# Autodesk Inventor assembly: CartesianRobotWorkSpace
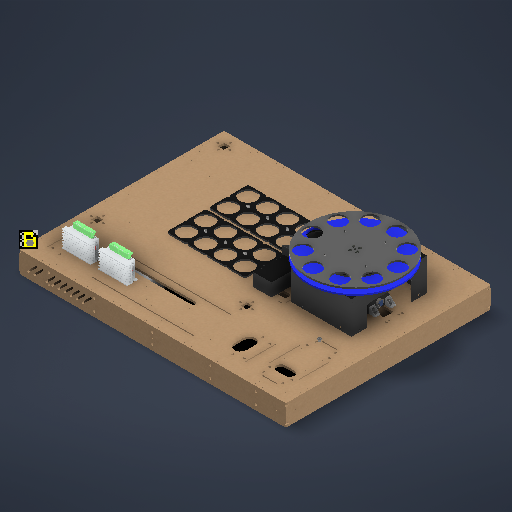
[picture p0: Inventor's stored thumbnail of the model, 512x512]
Saved by Autodesk Inventor 2027.1 (Build 311270010, 270A)
## iProperties
Created: 2026-09-29
Part Number: CartesianRobotWorkSpace
Document SubType Name: Assembly
Designer: SDS Scholar
Author: SDS Scholar
## Documents named in this file (37)
- C:\Users\Ahmed\Desktop\Fall 26\Design 1 Repo\MCT333_Design_of_Mechatronics_Systems_1\CAD\full_assembly\FullAssembly.iam
- C:\Users\Ahmed\Desktop\Fall 26\Design 1 Repo\MCT333_Design_of_Mechatronics_Systems_1\CAD\boxes\base_box\BaseBox.iam
- C:\Users\Ahmed\Desktop\Fall 26\Design 1 Repo\MCT333_Design_of_Mechatronics_Systems_1\CAD\cartesian_robot_workspace\CartesianRobotWorkSpace.iam
- C:\Users\Ahmed\Desktop\Fall 26\Design 1 Repo\MCT333_Design_of_Mechatronics_Systems_1\CAD\boxes\power_box\PowerBox.iam
- C:\Users\Ahmed\Desktop\Fall 26\Design 1 Repo\MCT333_Design_of_Mechatronics_Systems_1\CAD\FEED and Sorting\Assembly1.iam
- C:\Users\Ahmed\Desktop\Fall 26\Design 1 Repo\MCT333_Design_of_Mechatronics_Systems_1\CAD\boxes\control_box\ControlBox.iam
- C:\Users\Ahmed\Desktop\Fall 26\Design 1 Repo\MCT333_Design_of_Mechatronics_Systems_1\CAD\pnumatic_components\pneumatic_cylinder_double_action_mal16x75\AutodeskInventor\PneumaticAirCylinder.iam
- C:\Users\Ahmed\Desktop\Fall 26\Design 1 Repo\MCT333_Design_of_Mechatronics_Systems_1\CAD\FEED and Sorting\sorting_area\SortingArea.iam
- E:\Apps\AutodeskInventor\University\MCT333_Design_of_Mechatronics_Systems_1\CAD\electronic_components\esp32-38-pin-narrow-screw-terminal-breakout-board\ESP32 38 pin Screw terminal breakout board v11\ESP32 38 pi.ipt
- C:\Users\Ahmed\Desktop\Fall 26\Design 1 Repo\MCT333_Design_of_Mechatronics_Systems_1\CAD\motors_and_actuators\smakn-tb6600-stepper-motor-driver\SMAKN TB6600 Stepper Motor Driver\SMAKN TB6600 Stepper Motor Driver.ipt
- C:\Users\Ahmed\Desktop\Fall 26\Design 1 Repo\MCT333_Design_of_Mechatronics_Systems_1\CAD\motors_and_actuators\l298n-DC-motor-driver-red\L298N Stepper Motor Driver (Red)\L298N Stepper Motor Driver (Red).ipt
- C:\Users\Ahmed\Desktop\Fall 26\Design 1 Repo\MCT333_Design_of_Mechatronics_Systems_1\CAD\Product CAD\Product 1.iam
- C:\Users\Ahmed\Desktop\Fall 26\Design 1 Repo\MCT333_Design_of_Mechatronics_Systems_1\CAD\cartesian_robot_workspace\Z_Axis_1\Y Chain Path.ipt
- C:\Users\Ahmed\Desktop\Fall 26\Design 1 Repo\MCT333_Design_of_Mechatronics_Systems_1\CAD\cartesian_robot_workspace\Z_Axis_1\Drag Chain Middle Link.ipt
- C:\Users\Ahmed\Desktop\Fall 26\Design 1 Repo\MCT333_Design_of_Mechatronics_Systems_1\CAD\cartesian_robot_workspace\Z_Axis_1\X Chain Path.ipt
- C:\Users\Ahmed\Desktop\Fall 26\Design 1 Repo\MCT333_Design_of_Mechatronics_Systems_1\CAD\PowerDist_PCB_CAD\PowerDist_PCB_CAD.ipt
- C:\Users\Ahmed\Documents\Inventor\Content Center Files\R2027\en-US\ANSI B18.22 M\ANSI B18.22M - 5 N.ipt
- C:\Users\Ahmed\Documents\Inventor\Content Center Files\R2027\en-US\ANSI B18.22 M\ANSI B18.22M - 3 N.ipt
- C:\Users\SDS Scholar\Documents\Inventor\Content Center Files\R2027\en-US\ANSI B 18.2.4.1 M(1)\ANSI B 18.2.4.1 M - M3 x 0.5Style 1.ipt
- C:\Users\SDS Scholar\Documents\Inventor\Content Center Files\R2027\en-US\SS-ISO 4762\ISO 4762 - M3 x 16SS-ISO.ipt
- C:\Users\Ahmed\Desktop\Fall 26\Design 1 Repo\MCT333_Design_of_Mechatronics_Systems_1\CAD\electronic_components\esp32_38_pines\PCB_ESP32-38Pines\PCB_ESP32-38Pines.ipt
- C:\Users\Ahmed\Desktop\Fall 26\Design 1 Repo\MCT333_Design_of_Mechatronics_Systems_1\CAD\en-US\en-US\SS-ISO 4762\ISO 4762 - M5 x 16ISO.ipt
- C:\Users\SDS Scholar\Documents\Inventor\Content Center Files\R2027\en-US\ANSI B 18.2.4.1 M(1)\ANSI B 18.2.4.1 M - M5 x 0.8Style 2.ipt
- C:\Users\SDS Scholar\Documents\Inventor\Content Center Files\R2027\en-US\ANSI B18.22 M\ANSI B18.22M - 1.6 N.ipt
- C:\Users\SDS Scholar\Documents\Inventor\Content Center Files\R2027\en-US\ANSI B 18.2.4.1 M(1)\ANSI B 18.2.4.1 M - M1.6 x 0.35Style 1.ipt
- C:\Users\SDS Scholar\Documents\Inventor\Content Center Files\R2027\en-US\SS-ISO 4762\ISO 4762 - M1.6 x 12SS-ISO.ipt
- C:\Users\Ahmed\Desktop\Fall 26\Design 1 Repo\MCT333_Design_of_Mechatronics_Systems_1\CAD\fastners\nuts\ANSI B 18.2.4.1 M - M5 x 0.8Style 1.ipt
- C:\Users\SDS Scholar\Documents\Inventor\Content Center Files\R2027\en-US\BS EN ISO 7045 H\EN ISO 7045 - M5 x 20 - 4.8 - H(1).ipt
- C:\Users\Ahmed\Desktop\Fall 26\Design 1 Repo\MCT333_Design_of_Mechatronics_Systems_1\CAD\electronic_components\5v-laser-detection-receiver\Laser Detection Hardware\Laser Detection Hardware.ipt
- C:\Users\Ahmed\Desktop\Fall 26\Design 1 Repo\MCT333_Design_of_Mechatronics_Systems_1\CAD\pnumatic_components\4V110-06, 2 POSITION, 5 WAY SOLENOID VALVE\4V110-06, 2 POSITION, 5 WAY SOLENOID VALVE\4V110-06, 2 POSITION, 5 .ipt
- C:\Users\SDS Scholar\Documents\Inventor\Content Center Files\R2027\en-US\SS-ISO 4762\ISO 4762 - M3 x 30SS-ISO.ipt
- C:\Users\Ahmed\Documents\Inventor\Content Center Files\R2027\en-US\ISO 4032(2)\ISO 4032 - M3 - ISO.ipt
- C:\Users\Ahmed\Desktop\Fall 26\Design 1 Repo\MCT333_Design_of_Mechatronics_Systems_1\CAD\ZK06_vacuum_generator\ZK06_vacuum_generator.ipt
- C:\Users\SDS Scholar\Documents\Inventor\Content Center Files\R2027\en-US\ANSI B18.22 M\ANSI B18.22M - 3.5 N.ipt
- C:\Users\SDS Scholar\Documents\Inventor\Content Center Files\R2027\en-US\BS EN ISO 7045 H\EN ISO 7045 - M3.5 x 35 - 4.8 - H(1).ipt
- C:\Users\SDS Scholar\Documents\Inventor\Content Center Files\R2027\en-US\ANSI B 18.2.4.1 M(1)\ANSI B 18.2.4.1 M - M3.5 x 0.6Style 1.ipt
- C:\Users\Ahmed\Desktop\Fall 26\Design 1 Repo\MCT333_Design_of_Mechatronics_Systems_1\CAD\DESIGN1_CAD_parameters.xlsx
## Components (186 placed, 34 different names)
1. BaseBox:1 [sub-assembly] — Flush:1, Flush:2, Flush:3, Mate:1, Mate:2, Mate:3, Mate:4, Mate:5, Flush:4, Mate:6, Mate:7, Angle:2, Flush:7, Mate:16, Mate:17, Mate:20, Mate:21, Flush:23, Mate:23, Mate:32, Mate:35, Mate:38, Mate:40, Mate:41, Mate:44, Mate:45, Mate:46, Flush:10, Mate:55, Mate:56, Mate:86, Mate:94, Angle:8, Mate:109, Mate:111, Mate:121, Mate:123, Mate:131, Mate:154, Mate:155, Mate:156, Mate:157, Insert:3, Insert:4, Insert:5, Mate:159, Mate:167, Mate:169, Mate:170, Mate:171, Mate:177, Mate:178
2. CartesianRobotWorkSpace:1 [sub-assembly] — Mate:1, Mate:2, Mate:3, Mate:4, Mate:5, Flush:8, Angle:4, Angle:5, Flush:9, Angle:6, Angle:7, Mate:117, Mate:118, Mate:119, Mate:120
3. Assembly1:1 [sub-assembly] — Mate:177, Mate:178
4. Product 1:1 [sub-assembly] — Mate:40, Mate:41
5. 4V110-06, 2 POSITION, 5 :1 — Mate:155, Mate:156, Mate:157, Insert:1, Insert:2
6. SS ISO 4762 M3 x 30:1 — Insert:1
7. SS ISO 4762 M3 x 30:2 — Insert:2
8. ISO 4032 M3:1 — Insert:3
9. ISO 4032 M3:2 — Insert:4
10. ISO 4032 M3:3 — Insert:5
11. PneumaticAirCylinder:1 [sub-assembly] — Angle:2, Mate:38, Mate:45, Mate:46, Mate:129, Mate:130
12. Plain Washer (Metric) 5 N:5 — Mate:97
13. Plain Washer (Metric) 5 N:6 — Mate:98
14. Plain Washer (Metric) 5 N:7 — Mate:99
15. Plain Washer (Metric) 5 N:8 — Mate:100
16. Hex Nut Metric M5 x 0.8:1 — Mate:103
17. Hex Nut Metric M5 x 0.8:2 — Mate:101
18. Hex Nut Metric M5 x 0.8:3 — Mate:102
19. Hex Nut Metric M5 x 0.8:4 — Mate:104
20. PCB_ESP32-38Pines:2 — Mate:95, Flush:14, Flush:15
21. ISO 4762 M5 x 16:2 — Mate:100, Mate:104
22. ISO 4762 M5 x 16:3 — Mate:97, Mate:102
23. ISO 4762 M5 x 16:4 — Mate:99, Mate:101
24. ISO 4762 M5 x 16:1 — Mate:98, Mate:103
25. SMAKN TB6600 Stepper Motor Driver:1 — Mate:56, Mate:57, Flush:12
26. SMAKN TB6600 Stepper Motor Driver:2 — Mate:55, Mate:57, Flush:12, Flush:13, Mate:58
27. PowerDist_PCB_CAD:1 — Mate:44, Angle:8, Flush:10, Flush:11, Mate:83, Mate:84
28. PowerBox:1 [sub-assembly] — Flush:4, Mate:6, Mate:7, Mate:25, Mate:33
29. ESP32 38 pi:1 — Mate:23, Mate:25, Flush:11, Mate:95, Flush:14, Flush:15, Mate:105, Mate:106
30. L298N Stepper Motor Driver (Red):1 — Mate:32, Mate:33, Flush:13, Mate:58, Mate:89, Mate:90
31. PCB_ESP32-38Pines:1 — Mate:96, Flush:16, Flush:17
32. ControlBox:1 [sub-assembly] — Mate:20, Mate:21, Flush:23, Mate:36, Mate:37
33. ESP32 38 pi:2 — Mate:35, Mate:36, Mate:37, Mate:96, Flush:16, Flush:17, Mate:107, Mate:108
34. Y Chain Path:1 — Flush:8, Mate:42
35. X Chain Path:1 — Flush:9, Mate:43
36. SortingArea:1 [sub-assembly] — Flush:7, Mate:16, Mate:17, Mate:153
37. Laser Detection Hardware:1 — Mate:153
38. Laser Detection Hardware:2 — Mate:154
39. ZK06_vacuum_generator:1 — Mate:158, Mate:159, Mate:160, Mate:161, Mate:163, Mate:170, Mate:171
40. BS EN ISO 7045 H - Metric M3.5 x 35 - 4.8 - H:1 — Mate:158, Mate:164, Mate:166, Mate:172, Mate:175
41. BS EN ISO 7045 H - Metric M3.5 x 35 - 4.8 - H:2 — Mate:160, Mate:162, Mate:165, Mate:168, Mate:173
42. Plain Washer (Metric) 3.5 N:1 — Mate:163, Mate:164, Mate:166
43. Plain Washer (Metric) 3.5 N:2 — Mate:169, Mate:172, Mate:174, Mate:176
44. Plain Washer (Metric) 3.5 N:3 — Mate:161, Mate:162, Mate:165
45. Plain Washer (Metric) 3.5 N:4 — Mate:167, Mate:168
46. Hex Nut Metric M3.5 x 0.6:1 — Mate:173, Mate:174
47. Hex Nut Metric M3.5 x 0.6:2 — Mate:175, Mate:176
48. BS EN ISO 7045 H - Metric M5 x 20 - 4.8 - H:1 — Mate:119, Mate:120, Mate:124, Mate:126
49. BS EN ISO 7045 H - Metric M5 x 20 - 4.8 - H:2 — Mate:117, Mate:118, Mate:122, Mate:128
50. Plain Washer (Metric) 5 N:9 — Mate:123, Mate:124, Mate:125
51. Plain Washer (Metric) 5 N:10 — Mate:121, Mate:122, Mate:127
52. Hex Nut Metric M5 x 0.8:5 — Mate:127, Mate:128
53. Hex Nut Metric M5 x 0.8:6 — Mate:125, Mate:126
54. BS EN ISO 7045 H - Metric M5 x 20 - 4.8 - H:3
55. BS EN ISO 7045 H - Metric M5 x 20 - 4.8 - H:4
56. Plain Washer (Metric) 5 N:11
57. Plain Washer (Metric) 5 N:12
58. Hex Nut Metric M5 x 0.8:7
59. Hex Nut Metric M5 x 0.8:8
60. BS EN ISO 7045 H - Metric M5 x 20 - 4.8 - H:5
61. BS EN ISO 7045 H - Metric M5 x 20 - 4.8 - H:6
62. Plain Washer (Metric) 5 N:13
63. Plain Washer (Metric) 5 N:14
64. Hex Nut Metric M5 x 0.8:9
65. Hex Nut Metric M5 x 0.8:10
66. BS EN ISO 7045 H - Metric M5 x 20 - 4.8 - H:7
67. BS EN ISO 7045 H - Metric M5 x 20 - 4.8 - H:8
68. Plain Washer (Metric) 5 N:15
69. Plain Washer (Metric) 5 N:16
70. Hex Nut Metric M5 x 0.8:11
71. Hex Nut Metric M5 x 0.8:12
72. BS EN ISO 7045 H - Metric M5 x 20 - 4.8 - H:9 — Mate:129, Mate:130, Mate:132, Mate:134
73. Plain Washer (Metric) 5 N:17 — Mate:131, Mate:132, Mate:133
74. Hex Nut Metric M5 x 0.8:13 — Mate:133, Mate:134
75. BS EN ISO 7045 H - Metric M5 x 20 - 4.8 - H:10
76. Plain Washer (Metric) 5 N:18
77. Hex Nut Metric M5 x 0.8:14
78. BS EN ISO 7045 H - Metric M5 x 20 - 4.8 - H:11
79. Plain Washer (Metric) 5 N:19
80. Hex Nut Metric M5 x 0.8:15
81. BS EN ISO 7045 H - Metric M5 x 20 - 4.8 - H:12
82. Plain Washer (Metric) 5 N:20
83. Hex Nut Metric M5 x 0.8:16
84. SS ISO 4762 M1.6 x 12:2 — Mate:105, Mate:106, Mate:110, Mate:116
85. Plain Washer (Metric) 1.6 N:2 — Mate:109, Mate:110, Mate:115
86. Hex Nut Metric M1.6 x 0.35:2 — Mate:115, Mate:116
87. SS ISO 4762 M1.6 x 12:3
88. Plain Washer (Metric) 1.6 N:3
89. Hex Nut Metric M1.6 x 0.35:4
90. SS ISO 4762 M1.6 x 12:4
91. Plain Washer (Metric) 1.6 N:4
92. Hex Nut Metric M1.6 x 0.35:5
93. SS ISO 4762 M1.6 x 12:5
94. Plain Washer (Metric) 1.6 N:5
95. Hex Nut Metric M1.6 x 0.35:6
96. SS ISO 4762 M3 x 16:1 — Mate:83, Mate:84, Mate:85, Mate:87
97. Hex Nut Metric M3 x 0.5:1 — Mate:87, Mate:88
98. Plain Washer (Metric) 3 N:1 — Mate:85, Mate:86, Mate:88
99. SS ISO 4762 M3 x 16:2
100. Hex Nut Metric M3 x 0.5:2
101. Plain Washer (Metric) 3 N:2
102. SS ISO 4762 M3 x 16:3
103. Hex Nut Metric M3 x 0.5:3
104. Plain Washer (Metric) 3 N:3
105. SS ISO 4762 M3 x 16:4
106. Hex Nut Metric M3 x 0.5:4
107. Plain Washer (Metric) 3 N:4
108. SS ISO 4762 M3 x 16:5 — Mate:89, Mate:90, Mate:91, Mate:93
109. Hex Nut Metric M3 x 0.5:5 — Mate:92, Mate:93
110. Plain Washer (Metric) 3 N:5 — Mate:91, Mate:92, Mate:94
111. SS ISO 4762 M3 x 16:6
112. Hex Nut Metric M3 x 0.5:6
113. Plain Washer (Metric) 3 N:6
114. SS ISO 4762 M3 x 16:7
115. Hex Nut Metric M3 x 0.5:7
116. Plain Washer (Metric) 3 N:7
117. SS ISO 4762 M3 x 16:8
118. Hex Nut Metric M3 x 0.5:8
119. Plain Washer (Metric) 3 N:8
120. Plain Washer (Metric) 1.6 N:1 — Mate:111, Mate:112, Mate:113
121. Hex Nut Metric M1.6 x 0.35:3 — Mate:113, Mate:114
122. SS ISO 4762 M1.6 x 12:1 — Mate:107, Mate:108, Mate:112, Mate:114
123. Plain Washer (Metric) 1.6 N:6
124. Hex Nut Metric M1.6 x 0.35:7
125. SS ISO 4762 M1.6 x 12:6
126. Plain Washer (Metric) 1.6 N:7
127. Hex Nut Metric M1.6 x 0.35:8
128. SS ISO 4762 M1.6 x 12:7
129. Plain Washer (Metric) 1.6 N:8
130. Hex Nut Metric M1.6 x 0.35:9
131. SS ISO 4762 M1.6 x 12:8
132. Drag Chain Middle Link:1 — Mate:42, Angle:4, Angle:5
133. Drag Chain Middle Link:2
134. Drag Chain Middle Link:3
135. Drag Chain Middle Link:4
136. Drag Chain Middle Link:5
137. Drag Chain Middle Link:6
138. Drag Chain Middle Link:7
139. Drag Chain Middle Link:8
140. Drag Chain Middle Link:9
141. Drag Chain Middle Link:10
142. Drag Chain Middle Link:11
143. Drag Chain Middle Link:12
144. Drag Chain Middle Link:13
145. Drag Chain Middle Link:14
146. Drag Chain Middle Link:15
147. Drag Chain Middle Link:16
148. Drag Chain Middle Link:17
149. Drag Chain Middle Link:18
150. Drag Chain Middle Link:19
151. Drag Chain Middle Link:20
152. Drag Chain Middle Link:21
153. Drag Chain Middle Link:22
154. Drag Chain Middle Link:23
155. Drag Chain Middle Link:24
156. Drag Chain Middle Link:25
157. Drag Chain Middle Link:26
158. Drag Chain Middle Link:27
159. Drag Chain Middle Link:28
160. Drag Chain Middle Link:29
161. Drag Chain Middle Link:30
162. Drag Chain Middle Link:31 — Mate:43, Angle:6, Angle:7
163. Drag Chain Middle Link:32
164. Drag Chain Middle Link:33
165. Drag Chain Middle Link:34
166. Drag Chain Middle Link:35
167. Drag Chain Middle Link:36
168. Drag Chain Middle Link:37
169. Drag Chain Middle Link:38
170. Drag Chain Middle Link:39
171. Drag Chain Middle Link:40
172. Drag Chain Middle Link:41
173. Drag Chain Middle Link:42
174. Drag Chain Middle Link:43
175. Drag Chain Middle Link:44
176. Drag Chain Middle Link:45
177. Drag Chain Middle Link:46
178. Drag Chain Middle Link:47
179. Drag Chain Middle Link:48
180. Drag Chain Middle Link:49
181. Drag Chain Middle Link:50
182. Drag Chain Middle Link:51
183. Drag Chain Middle Link:52
184. Drag Chain Middle Link:53
185. Drag Chain Middle Link:54
186. Drag Chain Middle Link:55
## Component patterns: (4 elements, first: BS EN ISO 7045 H - Metric M5 x 20 - 4.8 - H:1 + BS EN ISO 7045 H - Metric M5 x 20 - 4.8 - H:2 + Plain Washer (Metric) 5 N:9 + Plain Washer (Metric) 5 N:10 + Hex Nut Metric M5 x 0.8:5 + Hex Nut Metric M5 x 0.8:6), (4 elements, first: BS EN ISO 7045 H - Metric M5 x 20 - 4.8 - H:9 + Plain Washer (Metric) 5 N:17 + Hex Nut Metric M5 x 0.8:13), (4 elements, first: SS ISO 4762 M1.6 x 12:2 + Plain Washer (Metric) 1.6 N:2 + Hex Nut Metric M1.6 x 0.35:2), (4 elements, first: SS ISO 4762 M3 x 16:1 + Hex Nut Metric M3 x 0.5:1 + Plain Washer (Metric) 3 N:1), (4 elements, first: SS ISO 4762 M3 x 16:5 + Hex Nut Metric M3 x 0.5:5 + Plain Washer (Metric) 3 N:5), (4 elements, first: Plain Washer (Metric) 1.6 N:1 + Hex Nut Metric M1.6 x 0.35:3 + SS ISO 4762 M1.6 x 12:1), (30 elements, first: Drag Chain Middle Link:1), (25 elements, first: Drag Chain Middle Link:31)
## Relationships (143: Mate 116, Flush 16, Angle 6, Insert 5)
- Flush:1: BaseBox:1
- Flush:2: BaseBox:1
- Flush:3: BaseBox:1
- Mate:1: BaseBox:1 ↔ CartesianRobotWorkSpace:1
- Mate:2: BaseBox:1 ↔ CartesianRobotWorkSpace:1
- Mate:3: BaseBox:1 ↔ CartesianRobotWorkSpace:1
- Mate:4: BaseBox:1 ↔ CartesianRobotWorkSpace:1
- Mate:5: BaseBox:1 ↔ CartesianRobotWorkSpace:1
- Flush:4: BaseBox:1 ↔ PowerBox:1
- Mate:6: BaseBox:1 ↔ PowerBox:1
- Mate:7: BaseBox:1 ↔ PowerBox:1
- Angle:2 (180 deg): BaseBox:1 ↔ PneumaticAirCylinder:1
- Flush:7: BaseBox:1 ↔ SortingArea:1
- Mate:16: BaseBox:1 ↔ SortingArea:1
- Mate:17: BaseBox:1 ↔ SortingArea:1
- Mate:20: BaseBox:1 ↔ ControlBox:1
- Mate:21: BaseBox:1 ↔ ControlBox:1
- Flush:23: BaseBox:1 ↔ ControlBox:1
- Mate:23: BaseBox:1 ↔ ESP32 38 pi:1
- Mate:25 (370 mm): PowerBox:1 ↔ ESP32 38 pi:1
- Mate:32: BaseBox:1 ↔ L298N Stepper Motor Driver (Red):1
- Mate:33 (30 mm): PowerBox:1 ↔ L298N Stepper Motor Driver (Red):1
- Mate:35: BaseBox:1 ↔ ESP32 38 pi:2
- Mate:36 (7.5 mm): ControlBox:1 ↔ ESP32 38 pi:2
- Mate:37 (10 mm): ControlBox:1 ↔ ESP32 38 pi:2
- Mate:38: BaseBox:1 ↔ PneumaticAirCylinder:1
- Mate:40: BaseBox:1 ↔ Product 1:1
- Mate:41: BaseBox:1 ↔ Product 1:1
- Flush:8: CartesianRobotWorkSpace:1 ↔ Y Chain Path:1
- Mate:42: Y Chain Path:1 ↔ Drag Chain Middle Link:1
- Angle:4 (0 deg): CartesianRobotWorkSpace:1 ↔ Drag Chain Middle Link:1
- Angle:5 (0 deg): CartesianRobotWorkSpace:1 ↔ Drag Chain Middle Link:1
- Flush:9: CartesianRobotWorkSpace:1 ↔ X Chain Path:1
- Mate:43: X Chain Path:1 ↔ Drag Chain Middle Link:31
- Angle:6 (0 deg): CartesianRobotWorkSpace:1 ↔ Drag Chain Middle Link:31
- Angle:7 (0 deg): CartesianRobotWorkSpace:1 ↔ Drag Chain Middle Link:31
- Mate:44: BaseBox:1 ↔ PowerDist_PCB_CAD:1
- Angle:8 (0 deg): BaseBox:1 ↔ PowerDist_PCB_CAD:1
- Mate:45: BaseBox:1 ↔ PneumaticAirCylinder:1
- Mate:46: BaseBox:1 ↔ PneumaticAirCylinder:1
- Flush:10 (20 mm): BaseBox:1 ↔ PowerDist_PCB_CAD:1
- Flush:11: PowerDist_PCB_CAD:1 ↔ ESP32 38 pi:1
- Mate:55: BaseBox:1 ↔ SMAKN TB6600 Stepper Motor Driver:2
- Mate:56: BaseBox:1 ↔ SMAKN TB6600 Stepper Motor Driver:1
- Mate:57 (40 mm): SMAKN TB6600 Stepper Motor Driver:1 ↔ SMAKN TB6600 Stepper Motor Driver:2
- Flush:12: SMAKN TB6600 Stepper Motor Driver:1 ↔ SMAKN TB6600 Stepper Motor Driver:2
- Flush:13: SMAKN TB6600 Stepper Motor Driver:2 ↔ L298N Stepper Motor Driver (Red):1
- Mate:58 (20 mm): SMAKN TB6600 Stepper Motor Driver:2 ↔ L298N Stepper Motor Driver (Red):1
- [Mate]: ISO 4762 M5 x 16:4 ↔ SMAKN TB6600 Stepper Motor Driver:2
- [Mate]: ISO 4762 M5 x 16:3 ↔ SMAKN TB6600 Stepper Motor Driver:2
- [Mate]: ISO 4762 M5 x 16:2 ↔ SMAKN TB6600 Stepper Motor Driver:1
- [Mate]: ISO 4762 M5 x 16:1 ↔ SMAKN TB6600 Stepper Motor Driver:1
- [Mate]: ISO 4762 M5 x 16:4 ↔ SMAKN TB6600 Stepper Motor Driver:2
- [Mate]: ISO 4762 M5 x 16:3 ↔ SMAKN TB6600 Stepper Motor Driver:2
- [Mate]: ISO 4762 M5 x 16:1 ↔ SMAKN TB6600 Stepper Motor Driver:1
- [Mate]: ISO 4762 M5 x 16:2 ↔ SMAKN TB6600 Stepper Motor Driver:1
- Mate:83: PowerDist_PCB_CAD:1 ↔ SS ISO 4762 M3 x 16:1
- Mate:84: PowerDist_PCB_CAD:1 ↔ SS ISO 4762 M3 x 16:1
- Mate:85: SS ISO 4762 M3 x 16:1 ↔ Plain Washer (Metric) 3 N:1
- Mate:86: BaseBox:1 ↔ Plain Washer (Metric) 3 N:1
- Mate:87: SS ISO 4762 M3 x 16:1 ↔ Hex Nut Metric M3 x 0.5:1
- Mate:88: Hex Nut Metric M3 x 0.5:1 ↔ Plain Washer (Metric) 3 N:1
- Mate:89: L298N Stepper Motor Driver (Red):1 ↔ SS ISO 4762 M3 x 16:5
- Mate:90: L298N Stepper Motor Driver (Red):1 ↔ SS ISO 4762 M3 x 16:5
- Mate:91: SS ISO 4762 M3 x 16:5 ↔ Plain Washer (Metric) 3 N:5
- Mate:92: Hex Nut Metric M3 x 0.5:5 ↔ Plain Washer (Metric) 3 N:5
- Mate:93: SS ISO 4762 M3 x 16:5 ↔ Hex Nut Metric M3 x 0.5:5
- Mate:94: BaseBox:1 ↔ Plain Washer (Metric) 3 N:5
- Mate:95: PCB_ESP32-38Pines:2 ↔ ESP32 38 pi:1
- Flush:14: PCB_ESP32-38Pines:2 ↔ ESP32 38 pi:1
- Flush:15: PCB_ESP32-38Pines:2 ↔ ESP32 38 pi:1
- Mate:96: PCB_ESP32-38Pines:1 ↔ ESP32 38 pi:2
- Flush:16: PCB_ESP32-38Pines:1 ↔ ESP32 38 pi:2
- Flush:17: PCB_ESP32-38Pines:1 ↔ ESP32 38 pi:2
- Mate:97: Plain Washer (Metric) 5 N:5 ↔ ISO 4762 M5 x 16:3
- Mate:98: Plain Washer (Metric) 5 N:6 ↔ ISO 4762 M5 x 16:1
- Mate:99: Plain Washer (Metric) 5 N:7 ↔ ISO 4762 M5 x 16:4
- Mate:100: Plain Washer (Metric) 5 N:8 ↔ ISO 4762 M5 x 16:2
- Mate:101: Hex Nut Metric M5 x 0.8:2 ↔ ISO 4762 M5 x 16:4
- Mate:102: Hex Nut Metric M5 x 0.8:3 ↔ ISO 4762 M5 x 16:3
- Mate:103: Hex Nut Metric M5 x 0.8:1 ↔ ISO 4762 M5 x 16:1
- Mate:104: Hex Nut Metric M5 x 0.8:4 ↔ ISO 4762 M5 x 16:2
- Mate:105: ESP32 38 pi:1 ↔ SS ISO 4762 M1.6 x 12:2
- Mate:106: ESP32 38 pi:1 ↔ SS ISO 4762 M1.6 x 12:2
- Mate:107: ESP32 38 pi:2 ↔ SS ISO 4762 M1.6 x 12:1
- Mate:108: ESP32 38 pi:2 ↔ SS ISO 4762 M1.6 x 12:1
- Mate:109: BaseBox:1 ↔ Plain Washer (Metric) 1.6 N:2
- Mate:110: SS ISO 4762 M1.6 x 12:2 ↔ Plain Washer (Metric) 1.6 N:2
- Mate:111: BaseBox:1 ↔ Plain Washer (Metric) 1.6 N:1
- Mate:112: Plain Washer (Metric) 1.6 N:1 ↔ SS ISO 4762 M1.6 x 12:1
- Mate:113: Plain Washer (Metric) 1.6 N:1 ↔ Hex Nut Metric M1.6 x 0.35:3
- Mate:114: Hex Nut Metric M1.6 x 0.35:3 ↔ SS ISO 4762 M1.6 x 12:1
- Mate:115: Plain Washer (Metric) 1.6 N:2 ↔ Hex Nut Metric M1.6 x 0.35:2
- Mate:116: SS ISO 4762 M1.6 x 12:2 ↔ Hex Nut Metric M1.6 x 0.35:2
- Mate:117: CartesianRobotWorkSpace:1 ↔ BS EN ISO 7045 H - Metric M5 x 20 - 4.8 - H:2
- Mate:118: CartesianRobotWorkSpace:1 ↔ BS EN ISO 7045 H - Metric M5 x 20 - 4.8 - H:2
- Mate:119: CartesianRobotWorkSpace:1 ↔ BS EN ISO 7045 H - Metric M5 x 20 - 4.8 - H:1
- Mate:120: CartesianRobotWorkSpace:1 ↔ BS EN ISO 7045 H - Metric M5 x 20 - 4.8 - H:1
- Mate:121: BaseBox:1 ↔ Plain Washer (Metric) 5 N:10
- Mate:122: BS EN ISO 7045 H - Metric M5 x 20 - 4.8 - H:2 ↔ Plain Washer (Metric) 5 N:10
- Mate:123: BaseBox:1 ↔ Plain Washer (Metric) 5 N:9
- Mate:124: BS EN ISO 7045 H - Metric M5 x 20 - 4.8 - H:1 ↔ Plain Washer (Metric) 5 N:9
- Mate:125: Plain Washer (Metric) 5 N:9 ↔ Hex Nut Metric M5 x 0.8:6
- Mate:126: BS EN ISO 7045 H - Metric M5 x 20 - 4.8 - H:1 ↔ Hex Nut Metric M5 x 0.8:6
- Mate:127: Plain Washer (Metric) 5 N:10 ↔ Hex Nut Metric M5 x 0.8:5
- Mate:128: BS EN ISO 7045 H - Metric M5 x 20 - 4.8 - H:2 ↔ Hex Nut Metric M5 x 0.8:5
- Mate:129: PneumaticAirCylinder:1 ↔ BS EN ISO 7045 H - Metric M5 x 20 - 4.8 - H:9
- Mate:130: PneumaticAirCylinder:1 ↔ BS EN ISO 7045 H - Metric M5 x 20 - 4.8 - H:9
- Mate:131: BaseBox:1 ↔ Plain Washer (Metric) 5 N:17
- Mate:132: BS EN ISO 7045 H - Metric M5 x 20 - 4.8 - H:9 ↔ Plain Washer (Metric) 5 N:17
- Mate:133: Plain Washer (Metric) 5 N:17 ↔ Hex Nut Metric M5 x 0.8:13
- Mate:134: BS EN ISO 7045 H - Metric M5 x 20 - 4.8 - H:9 ↔ Hex Nut Metric M5 x 0.8:13
- Mate:153: SortingArea:1 ↔ Laser Detection Hardware:1
- Mate:154: BaseBox:1 ↔ Laser Detection Hardware:2
- Mate:155: BaseBox:1 ↔ 4V110-06, 2 POSITION, 5 :1
- Mate:156: BaseBox:1 ↔ 4V110-06, 2 POSITION, 5 :1
- Mate:157: BaseBox:1 ↔ 4V110-06, 2 POSITION, 5 :1
- Insert:1: 4V110-06, 2 POSITION, 5 :1 ↔ SS ISO 4762 M3 x 30:1
- Insert:2: 4V110-06, 2 POSITION, 5 :1 ↔ SS ISO 4762 M3 x 30:2
- Insert:3: BaseBox:1 ↔ ISO 4032 M3:1
- Insert:4: BaseBox:1 ↔ ISO 4032 M3:2
- Insert:5: BaseBox:1 ↔ ISO 4032 M3:3
- Mate:158: ZK06_vacuum_generator:1 ↔ BS EN ISO 7045 H - Metric M3.5 x 35 - 4.8 - H:1
- Mate:159: BaseBox:1 ↔ ZK06_vacuum_generator:1
- Mate:160: ZK06_vacuum_generator:1 ↔ BS EN ISO 7045 H - Metric M3.5 x 35 - 4.8 - H:2
- Mate:161: ZK06_vacuum_generator:1 ↔ Plain Washer (Metric) 3.5 N:3
- Mate:162: BS EN ISO 7045 H - Metric M3.5 x 35 - 4.8 - H:2 ↔ Plain Washer (Metric) 3.5 N:3
- Mate:163: ZK06_vacuum_generator:1 ↔ Plain Washer (Metric) 3.5 N:1
- Mate:164: BS EN ISO 7045 H - Metric M3.5 x 35 - 4.8 - H:1 ↔ Plain Washer (Metric) 3.5 N:1
- Mate:165: BS EN ISO 7045 H - Metric M3.5 x 35 - 4.8 - H:2 ↔ Plain Washer (Metric) 3.5 N:3
- Mate:166: BS EN ISO 7045 H - Metric M3.5 x 35 - 4.8 - H:1 ↔ Plain Washer (Metric) 3.5 N:1
- Mate:167: BaseBox:1 ↔ Plain Washer (Metric) 3.5 N:4
- Mate:168: BS EN ISO 7045 H - Metric M3.5 x 35 - 4.8 - H:2 ↔ Plain Washer (Metric) 3.5 N:4
- Mate:169: BaseBox:1 ↔ Plain Washer (Metric) 3.5 N:2
- Mate:170: BaseBox:1 ↔ ZK06_vacuum_generator:1
- Mate:171: BaseBox:1 ↔ ZK06_vacuum_generator:1
- Mate:172: BS EN ISO 7045 H - Metric M3.5 x 35 - 4.8 - H:1 ↔ Plain Washer (Metric) 3.5 N:2
- Mate:173: BS EN ISO 7045 H - Metric M3.5 x 35 - 4.8 - H:2 ↔ Hex Nut Metric M3.5 x 0.6:1
- Mate:174: Plain Washer (Metric) 3.5 N:2 ↔ Hex Nut Metric M3.5 x 0.6:1
- Mate:175: BS EN ISO 7045 H - Metric M3.5 x 35 - 4.8 - H:1 ↔ Hex Nut Metric M3.5 x 0.6:2
- Mate:176: Plain Washer (Metric) 3.5 N:2 ↔ Hex Nut Metric M3.5 x 0.6:2
- Mate:177: BaseBox:1 ↔ Assembly1:1
- Mate:178: BaseBox:1 ↔ Assembly1:1
## Named parameters: Product_dia = 50 mm, ProductBaseHeight = 40 mm, ProductLedHeight = 20 mm, GridProcutClearance = 5 mm, GridBorderThickness = 5 mm, GridBorderFillets = 7 mm, GridTotalSize = 65 mm, GridRobotClearance = 65 mm, AluminiumExtrusionBase = 20 mm, AluminiumExtrusionClearance = 35 mm, BaseTotalWidth = 680 mm, FeedingAreaLength = 340 mm, BaseTotalLength = 885 mm, DistanceBetweenGrid = 10 mm, WorkspaceLength = 515 mm, WorkspaceWidth = 440 mm, WorkspaceHeight = 183 mm, AxesBaseFillet = 15 mm, Zaxis = 197 mm, ProductTotalHeight = 45 mm, VerticalClearance = 20 mm, VerticalStroke = 105 mm, FrontArea = 50 mm, BackArea = 165 mm, CylinderStroke = 75 mm, SideAreaWidth = 200 mm, BaseHeight = 70 mm, ContolBoxLength = 100 mm, DistanceBetweenBoxes = 30 mm, BoxesWidth = 125 mm, PowerBoxLength = 660 mm, PneumaticBoxLength = 200 mm, BoxesClearance = 40 mm, BoxesHeight = 80 mm, ContolBoxWidth = 200 mm, ControlBoxHeight = 70 mm, BaseWoodThickness = 7 mm, kerf = 1.5 mm, Kerf = 0.3 mm, TransmitterAreaWidth = 100 mm, RxThickness = 1.8 mm, wood_log = 50 mm, support_2 = 265 mm, support_1 = 160 mm
